# Autodesk Inventor assembly: RM4_ASSY
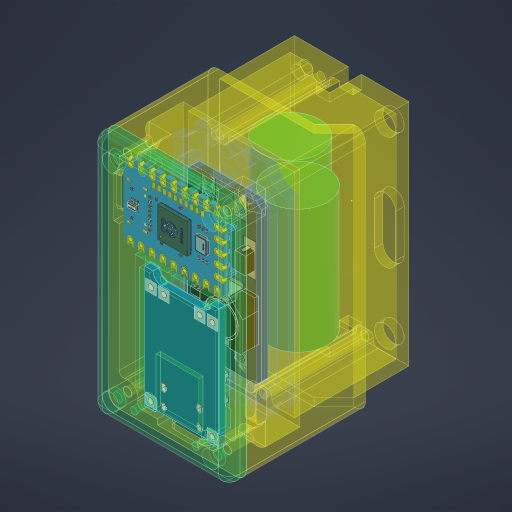
[picture p0: Inventor's stored thumbnail of the model, 512x512]
Saved by Autodesk Inventor 2024.3 (Build 283343000, 343)
## iProperties
Created: 2026-06-30
Part Number: RM4_ASSY
Document SubType Name: Assembly
Designer: REMOTE
Author: REMOTE
## Documents named in this file (9)
- C:\Users\REMOTE\Desktop\RM-4_3D\RM4_ASSY.iam
- C:\Users\REMOTE\Desktop\RM-4_3D\NEGATIVE.ipt
- C:\Users\REMOTE\Desktop\RM-4_3D\INNER.ipt
- C:\Users\REMOTE\Desktop\RM-4_3D\BAT.ipt
- C:\Users\REMOTE\Desktop\RM-4_3D\RP2040-ZERO-WAVESHARE.ipt
- C:\Users\REMOTE\Desktop\RM-4_3D\MT3608 v3\MT3608 v3\TP4056_Charging_Module_Type_C\TP4056_Charging_Module_Type_C\TP4056_Charging_Module_Type_C.iam
- C:\Users\REMOTE\Desktop\RM-4_3D\MT3608 v3\MT3608 v3\MT3608 v3.iam
- C:\Users\REMOTE\Desktop\RM-4_3D\MID_PLATE.ipt
- C:\Users\REMOTE\Desktop\RM-4_3D\CAP.ipt
## Components (9 placed, 8 different names)
1. NEGATIVE:1 — Mate:1, Mate:2, Mate:3
2. INNER:1 — Mate:1, Mate:2, Mate:3, Mate:9, Mate:10, Mate:11, Mate:12, Mate:13, Mate:14, Mate:15, Mate:18, Mate:19, Mate:21, Flush:4, Mate:23, Flush:6, Flush:7
3. BAT:1 — Mate:9, Mate:10, Mate:11, Flush:1
4. RP2040-ZERO-WAVESHARE:1 — Mate:19, Flush:5, Mate:22
5. TP4056_Charging_Module_Type_C:1 [sub-assembly] — Mate:18, Mate:21, Flush:4, Flush:5, Mate:22
6. MT3608 v3:1 [sub-assembly] — Mate:20, Flush:2, Flush:3
7. BAT:2 — Mate:12, Flush:1
8. MID_PLATE:1 — Mate:13, Mate:14, Mate:15, Mate:20, Flush:2, Flush:3
9. CAP:1 — Mate:23, Flush:6, Flush:7
## Relationships (23: Mate 16, Flush 7)
- Mate:1: NEGATIVE:1 ↔ INNER:1
- Mate:2 (0.1 mm): NEGATIVE:1 ↔ INNER:1
- Mate:3 (0.1 mm): NEGATIVE:1 ↔ INNER:1
- Mate:9 (7 mm): INNER:1 ↔ BAT:1
- Mate:10 (7 mm): INNER:1 ↔ BAT:1
- Mate:11 (11.3 mm): INNER:1 ↔ BAT:1
- Mate:12 (16 mm): INNER:1 ↔ BAT:2
- Flush:1: BAT:1 ↔ BAT:2
- Mate:13: INNER:1 ↔ MID_PLATE:1
- Mate:14 (0.15 mm): INNER:1 ↔ MID_PLATE:1
- Mate:15 (0.15 mm): INNER:1 ↔ MID_PLATE:1
- Mate:18 (0.15 mm): INNER:1 ↔ TP4056_Charging_Module_Type_C:1
- Mate:19 (0.15 mm): INNER:1 ↔ RP2040-ZERO-WAVESHARE:1
- Mate:20: MT3608 v3:1 ↔ MID_PLATE:1
- Flush:2 (7.35 mm): MT3608 v3:1 ↔ MID_PLATE:1
- Flush:3 (4.835 mm): MT3608 v3:1 ↔ MID_PLATE:1
- Mate:21 (4.95 mm): INNER:1 ↔ TP4056_Charging_Module_Type_C:1
- Flush:4 (1 mm): INNER:1 ↔ TP4056_Charging_Module_Type_C:1
- Flush:5 (-1 mm): RP2040-ZERO-WAVESHARE:1 ↔ TP4056_Charging_Module_Type_C:1
- Mate:22 (2.5 mm): RP2040-ZERO-WAVESHARE:1 ↔ TP4056_Charging_Module_Type_C:1
- Mate:23: INNER:1 ↔ CAP:1
- Flush:6: INNER:1 ↔ CAP:1
- Flush:7: INNER:1 ↔ CAP:1
